# Autodesk Inventor assembly: Enclosure Assembly
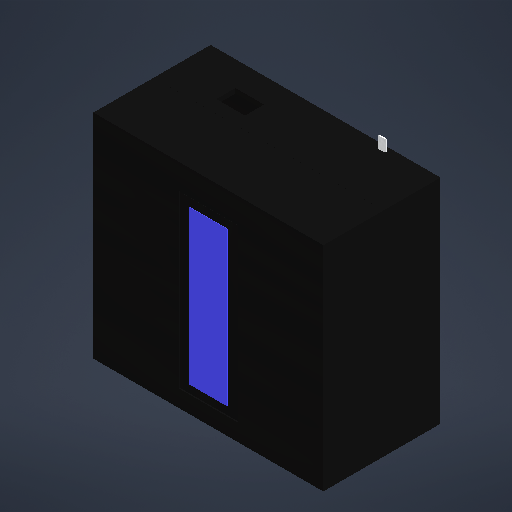
[picture p0: Inventor's stored thumbnail of the model, 512x512]
Saved by Autodesk Inventor 2027.2 (Build 312334000, 334)
## iProperties
Created: 2026-11-11
Part Number: Enclosure Assembly
Description: Reader enclosure with electronics, a pouch and an LFA strip inserted
Document SubType Name: Assembly
Designer: isaac
Author: isaac
## Documents named in this file (7)
- C:\Users\isaac\Optical-Sensing-Device\hardware\enclosure\Enclosure Assembly.iam
- C:\Users\isaac\Optical-Sensing-Device\hardware\enclosure\Electronics Assembly.iam
- C:\Users\isaac\Optical-Sensing-Device\hardware\enclosure\Enclosure\Enclosure Base.ipt
- C:\Users\isaac\Optical-Sensing-Device\hardware\enclosure\Enclosure\Optical Module.ipt
- C:\Users\isaac\Optical-Sensing-Device\hardware\enclosure\Enclosure\Enclosure Lid.ipt
- C:\Users\isaac\Optical-Sensing-Device\hardware\enclosure\Purchased Parts\DetectaChem\MobileDetect Pouch.ipt
- C:\Users\isaac\Optical-Sensing-Device\hardware\enclosure\Test Strips\LFA Strip (bare).ipt
## Components (6 placed, 6 different names)
1. Electronics Assembly:1 [sub-assembly]
2. Enclosure Base:1
3. Optical Module:1
4. Enclosure Lid:1
5. MobileDetect Pouch:1 — Pouch on floor, Pouch centred, Pouch insertion
6. LFA Strip (bare):1 — Strip on floor, Strip centred, Strip insertion
## Relationships (6: Flush 4, Mate 2)
- Pouch on floor [Flush]: MobileDetect Pouch:1
- Pouch centred [Mate]: MobileDetect Pouch:1
- Pouch insertion [Flush]: MobileDetect Pouch:1
- Strip on floor [Flush]: LFA Strip (bare):1
- Strip centred [Mate]: LFA Strip (bare):1
- Strip insertion [Flush]: LFA Strip (bare):1
## Named parameters: Insertion = 0 mm, InsertionMin = 0 mm, InsertionMax = 95 mm, StripInsertion = 0 mm, StripInsertionMin = 0 mm, StripInsertionMax = 80 mm
